# Autodesk Inventor assembly: RDS-GHN500-0000 Reagent Dosing Station
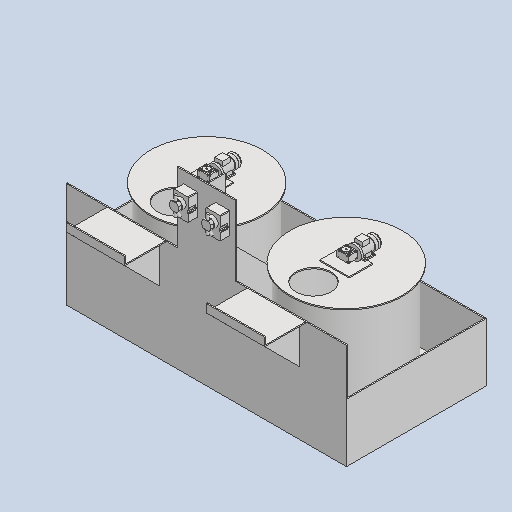
[picture p0: Inventor's stored thumbnail of the model, 512x512]
Saved by Autodesk Inventor 2026.2 (Build 302298000, 298)
## iProperties
Created: 2026-10-27
Part Number: RDS-GHN500-0000 Reagent Dosing Station
Document SubType Name: Assembly
Designer: user
Mass: 178086 g
Surface Area: 344199 cm^2
Volume: 178086 cm^3
Density: 1 g/cm^3
Author: user
## Documents named in this file (6)
- C:\Users\admin\Documents\Inventor\PRF-Parfino\RDS-GHN500-0000 Reagent Dosing Station.iam
- C:\Users\admin\Documents\Inventor\PRF-Parfino\RDS-GHN500-0000 Reagent Dosing Station\RDS-GHN500-1000 Container .iam
- C:\Users\admin\Documents\Inventor\PRF-Parfino\RDS-GHN500 Reagent Dosing Station\RDS-GHN500-2000 Tank.ipt
- C:\Users\admin\Documents\Inventor\PRF-Parfino\RDS-GHN500 Reagent Dosing Station\RDS-GHN500-2000 Tank2.ipt
- C:\Users\admin\Documents\Inventor\PRF-Parfino\Старые модели\СДР 030 Дозатор реагента .ipt
- C:\Users\admin\Documents\Inventor\PRF-Parfino\Старые модели\СДР 060 Мотор-редуктор 2.0.ipt
## Components (7 placed, 5 different names)
1. RDS-GHN500-1000 Container :1 [sub-assembly] — Rigid:1, Rotational:1, Mate:1, Flush:1, Flush:2, Mate:2, Flush:4, Flush:5
2. RDS-GHN500-2000 Tank:1 — Rigid:1, Rotational:3
3. RDS-GHN500-2000 Tank2:1 — Rotational:1, Rotational:2
4. СДР 030 Дозатор реагента :1 — Mate:1, Flush:1, Flush:2
5. СДР 030 Дозатор реагента :2 — Mate:2, Flush:4, Flush:5
6. СДР 060 Мотор-редуктор 2.0:1 — Rotational:2
7. СДР 060 Мотор-редуктор 2.0:2 — Rotational:3
## Relationships (10: Flush 4, RevoluteJoint 3, Mate 2, WeldJoint 1)
- Rigid:1 [WeldJoint]: RDS-GHN500-1000 Container :1 ↔ RDS-GHN500-2000 Tank:1
- Rotational:1 [RevoluteJoint]: RDS-GHN500-1000 Container :1 ↔ RDS-GHN500-2000 Tank2:1
- Mate:1: RDS-GHN500-1000 Container :1 ↔ СДР 030 Дозатор реагента :1
- Flush:1 (50 mm): RDS-GHN500-1000 Container :1 ↔ СДР 030 Дозатор реагента :1
- Flush:2 (100 mm): RDS-GHN500-1000 Container :1 ↔ СДР 030 Дозатор реагента :1
- Mate:2: RDS-GHN500-1000 Container :1 ↔ СДР 030 Дозатор реагента :2
- Flush:4 (50 mm): RDS-GHN500-1000 Container :1 ↔ СДР 030 Дозатор реагента :2
- Flush:5 (100 mm): RDS-GHN500-1000 Container :1 ↔ СДР 030 Дозатор реагента :2
- Rotational:2 [RevoluteJoint] (30 mm): RDS-GHN500-2000 Tank2:1 ↔ СДР 060 Мотор-редуктор 2.0:1
- Rotational:3 [RevoluteJoint] (30 mm): RDS-GHN500-2000 Tank:1 ↔ СДР 060 Мотор-редуктор 2.0:2
